# Autodesk Inventor assembly: inner subassembly
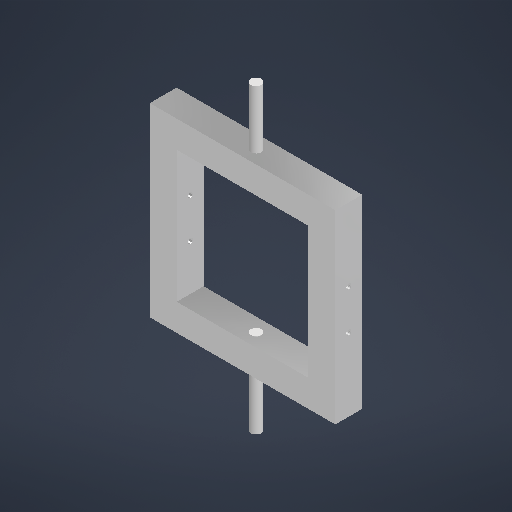
[picture p0: Inventor's stored thumbnail of the model, 512x512]
Saved by Autodesk Inventor 2026.1 (Build 301233000, 233)
## iProperties
Created: 2025-11-11
Part Number: inner subassembly
Document SubType Name: Assembly
Designer: shiva
Author: shiva
## Documents named in this file (3)
- D:\assignments\SEM 1\CAM\RPM\bigger version\inner sub assembly\inner subassembly.iam
- D:\assignments\SEM 1\CAM\RPM\bigger version\inner sub assembly\inner frame.ipt
- D:\assignments\SEM 1\CAM\RPM\bigger version\inner sub assembly\axle.ipt
## Components (3 placed, 2 different names)
1. inner frame:1 — Mate:1, Mate:2, Flush:1, Flush:2
2. axle:1 — Mate:1, Flush:1
3. axle:2 — Mate:2, Flush:2
## Relationships (4: Mate 2, Flush 2)
- Mate:1: inner frame:1 ↔ axle:1
- Mate:2: inner frame:1 ↔ axle:2
- Flush:1: inner frame:1 ↔ axle:1
- Flush:2: inner frame:1 ↔ axle:2
